# Autodesk Inventor assembly: MM0943AN106_G11_001
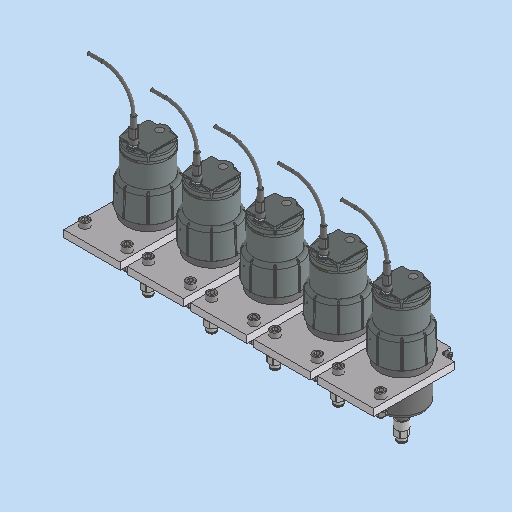
[picture p0: Inventor's stored thumbnail of the model, 512x512]
Saved by Autodesk Inventor 2023.3 (Build 273359000, 359)
## iProperties
Created: 2024-12-03
Part Number: MM0943AN106_G11_001
Description: =<RBPARTNOTITLE2>
Document SubType Name: Assembly
Designer: RIC7AN
Mass: 22048 g
Surface Area: 3370.14 cm^2
Volume: 2746.88 cm^3
Density: 8.02654 g/cm^3
RBPARTMADEOF: --
RBDRAWINGMISSINGSPEC: --
AnP_Kategorie: 99
RBPARTNOTITLE2: Schmierung
RBSURFACE: --
RBPARTNOTITLE1: lubrication
AnP_Material: =<Material>
RBMATERIAL: =<Material>
RBMATNO: =<Part Number>
RBPARTNO: SIEHE MNR
Author: RIC7AN
Keywords: =<RBPARTMADEOF>
Comments: =<RBSURFACE2>
Revision Number: 01
## Documents named in this file (8)
- C:\Users\rea9an\Documents\Inventor\TCAI2412_te1910_EM\AS00000925.iam
- C:\Users\rea9an\Documents\Inventor\TCAI2412_te1910_EM\PT00004492.ipt
- C:\Users\rea9an\Documents\Inventor\TCAI2412_te1910_EM\PT00004522.ipt
- C:\Users\rea9an\Documents\Inventor\TCAI2412_te1910_EM\PT00004883.ipt
- C:\Users\rea9an\Documents\Inventor\TCAI2412_te1910_EM\PT00004781.ipt
- C:\Users\rea9an\Documents\Inventor\TCAI2412_te1910_EM\PT00004821.ipt
- C:\Users\rea9an\Documents\Inventor\TCAI2412_te1910_EM\PT00004896.ipt
- C:\Users\rea9an\Documents\Inventor\TCAI2412_te1910_EM\PT00004508.ipt
## Components (50 placed, 7 different names)
1. PT00004492:1
2. PT00004821:2
3. PT00004781:2
4. PT00004896:2
5. PT00004896:1
6. PT00004821:1
7. PT00004781:1
8. PT00004883:1
9. PT00004522:1 — Einfügen:12
10. PT00004508:1 — Einfügen:12
11. PT00004492:2
12. PT00004821:3
13. PT00004781:3
14. PT00004896:3
15. PT00004896:4
16. PT00004821:4
17. PT00004781:4
18. PT00004883:2
19. PT00004522:2
20. PT00004508:2
21. PT00004492:3
22. PT00004821:5
23. PT00004781:5
24. PT00004896:5
25. PT00004896:6
26. PT00004821:6
27. PT00004781:6
28. PT00004883:3
29. PT00004522:3
30. PT00004508:3
31. PT00004492:4
32. PT00004821:7
33. PT00004781:7
34. PT00004896:7
35. PT00004896:8
36. PT00004821:8
37. PT00004781:8
38. PT00004883:4
39. PT00004522:4
40. PT00004508:4
41. PT00004492:5
42. PT00004821:9
43. PT00004781:9
44. PT00004896:9
45. PT00004896:10
46. PT00004821:10
47. PT00004781:10
48. PT00004883:5
49. PT00004522:5
50. PT00004508:5
## Component patterns: (5 elements, first: PT00004492:1 + PT00004821:2 + PT00004781:2 + PT00004896:2 + PT00004896:1 + PT00004821:1 + PT00004781:1 + PT00004883:1 + PT00004522:1 + PT00004508:1)
## Relationships (10: Insert 9, Angle 1)
- [Insert] (10 mm): PT00004492:1 ↔ PT00004522:1
- [Angle] (0 deg): PT00004492:1 ↔ PT00004522:1
- [Insert]: PT00004492:1 ↔ PT00004896:2
- [Insert]: PT00004492:1 ↔ PT00004896:1
- [Insert]: PT00004492:1 ↔ PT00004883:1
- [Insert]: PT00004821:1 ↔ PT00004781:1
- [Insert] (2.8 mm): PT00004896:1 ↔ PT00004821:1
- [Insert]: PT00004821:2 ↔ PT00004781:2
- [Insert] (2.8 mm): PT00004821:2 ↔ PT00004896:2
- Einfügen:12 [Insert]: PT00004522:1 ↔ PT00004508:1
## Named parameters: d453_d451 = 0 mm
